# Autodesk Inventor assembly: Assembly1
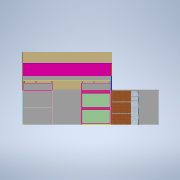
[picture p0: Inventor's stored thumbnail of the model, 180x180]
Saved by Autodesk Inventor 2022.6 (Build 266554000, 554)
## iProperties
RuleStatus: InUse
Created: 2026-10-19
Part Number: Assembly1
Document SubType Name: Assembly
Designer: Dragos Macovei
Author: Dragos Macovei
## Documents named in this file (55)
- C:\Users\Dragos Macovei\Documents\3D_Parts\PAT ADI\Assembly1.iam
- C:\Users\Dragos Macovei\Documents\3D_Parts\PAT ADI\despartitor_sub_pat_mare.ipt
- C:\Users\Dragos Macovei\Documents\3D_Parts\PAT ADI\assembly_sterar_superior.iam
- C:\Users\Dragos Macovei\Documents\3D_Parts\PAT ADI\assembly_sertar_inferior.iam
- C:\Users\Dragos Macovei\Documents\3D_Parts\PAT ADI\rigla_lemn_rindeluita_18x60x200.ipt
- C:\Users\Dragos Macovei\Documents\3D_Parts\PAT ADI\despartitor_sub_pat_mai_scurt_pe_culoar_mijloc.ipt
- C:\Users\Dragos Macovei\Documents\3D_Parts\PAT ADI\tablie_lungime_pat.ipt
- C:\Users\Dragos Macovei\Documents\3D_Parts\PAT ADI\blat_deasupra_sertarelor_de_la_pat.ipt
- C:\Users\Dragos Macovei\Documents\3D_Parts\PAT ADI\polita_sertar.ipt
- C:\Users\Dragos Macovei\Documents\3D_Parts\PAT ADI\cant_superior_sertare_sus.ipt
- C:\Users\Dragos Macovei\Documents\3D_Parts\PAT ADI\front_sertar_superior.ipt
- C:\Users\Dragos Macovei\Documents\3D_Parts\PAT ADI\front_usa_mid.ipt
- C:\Users\Dragos Macovei\Documents\3D_Parts\PAT ADI\front_sertar_mijlociu.ipt
- C:\Users\Dragos Macovei\Documents\3D_Parts\PAT ADI\jumatate_tablie_pat_jos.ipt
- C:\Users\Dragos Macovei\Documents\3D_Parts\PAT ADI\jumatate_tablie_pat_sus_cap.ipt
- C:\Users\Dragos Macovei\Documents\3D_Parts\PAT ADI\jumatate_tablie_pat_sus_picioare.ipt
- C:\Users\Dragos Macovei\Documents\3D_Parts\PAT ADI\capac_noptiera.ipt
- C:\Users\Dragos Macovei\Documents\3D_Parts\PAT ADI\dop_noptiera_picioare.ipt
- C:\Users\Dragos Macovei\Documents\3D_Parts\PAT ADI\rigla_lemn_rindeluita_18x60_dar_taiata_mai_mica.ipt
- C:\Users\Dragos Macovei\Documents\3D_Parts\PAT ADI\spate_sertare.ipt
- C:\Users\Dragos Macovei\Documents\3D_Parts\PAT ADI\balustrada_pal.ipt
- C:\Users\Dragos Macovei\Documents\3D_Parts\PAT ADI\laterala_treapta_jos.ipt
- C:\Users\Dragos Macovei\Documents\3D_Parts\PAT ADI\Treapta_1_capac.ipt
- C:\Users\Dragos Macovei\Documents\3D_Parts\PAT ADI\front_scara_sus.ipt
- C:\Users\Dragos Macovei\Documents\3D_Parts\PAT ADI\laterala_treapta_mijloc.ipt
- C:\Users\Dragos Macovei\Documents\3D_Parts\PAT ADI\laterala_treapta_sus.ipt
- C:\Users\Dragos Macovei\Documents\3D_Parts\PAT ADI\suport_Treapta_1_capac.ipt
- C:\Users\Dragos Macovei\Documents\3D_Parts\PAT ADI\suport_front_scara_sus.ipt
- C:\Users\Dragos Macovei\Documents\3D_Parts\PAT ADI\jumatate_tablie_pat_jos_la_picioare_unde_vin_treptele.ipt
- C:\Users\Dragos Macovei\Documents\3D_Parts\PAT ADI\blat.ipt
- C:\Users\Dragos Macovei\Documents\3D_Parts\PAT ADI\verticala_partea_dreapta_scara_jos.ipt
- C:\Users\Dragos Macovei\Documents\3D_Parts\PAT ADI\verticala_partea_dreapta_scara_mid.ipt
- C:\Users\Dragos Macovei\Documents\3D_Parts\PAT ADI\verticala_partea_dreapta_scara_sus.ipt
- C:\Users\Dragos Macovei\Documents\3D_Parts\PAT ADI\podea_scari_jos_pe_parchet.ipt
- C:\Users\Dragos Macovei\Documents\3D_Parts\PAT ADI\ultima verticala la tevi.ipt
- C:\Users\Dragos Macovei\Documents\3D_Parts\PAT ADI\suport_colt_teava.ipt
- C:\Users\Dragos Macovei\Documents\3D_Parts\PAT ADI\prindere_sub_blat_cutia_de_la_calorifer.ipt
- C:\Users\Dragos Macovei\Documents\3D_Parts\PAT ADI\polita_spatiu_liber_dintre_scara_si_box.ipt
- C:\Users\Dragos Macovei\Documents\3D_Parts\PAT ADI\laterala_box_sertare.ipt
- C:\Users\Dragos Macovei\Documents\3D_Parts\PAT ADI\top-bottom_box_sertare.ipt
- C:\Users\Dragos Macovei\Documents\3D_Parts\PAT ADI\sertar_inferior_trepte_assmbly.iam
- C:\Users\Dragos Macovei\Documents\3D_Parts\PAT ADI\sertar_superior_trepte.iam
- C:\Users\Dragos Macovei\Documents\3D_Parts\PAT ADI\front_sertare_dreapta_birou.ipt
- C:\Users\Dragos Macovei\Documents\3D_Parts\PAT ADI\front_sertar_scari.ipt
- C:\Users\Dragos Macovei\Documents\3D_Parts\PAT ADI\front_usa_box_tevi_apa.ipt
- C:\Users\Dragos Macovei\Documents\3D_Parts\PAT ADI\pfl_spate_corp_tevi_apa.ipt
- C:\Users\Dragos Macovei\Documents\3D_Parts\PAT ADI\front_suport_telefon_lateral.ipt
- C:\Users\Dragos Macovei\Documents\3D_Parts\PAT ADI\front_picioare_cutie_suport_telefon.ipt
- C:\Users\Dragos Macovei\Documents\3D_Parts\PAT ADI\pfl_spate_corp_3_sertare.ipt
- C:\Users\Dragos Macovei\Documents\3D_Parts\PAT ADI\intaritura_partea_din_spate_trepte.ipt
- C:\Users\Dragos Macovei\Documents\3D_Parts\PAT ADI\front_suport_telefon_sus.ipt
- C:\Users\Dragos Macovei\Documents\3D_Parts\PAT ADI\intaritura_partea_din_spate_cutie_tevi_cu_usa.ipt
- C:\Users\Dragos Macovei\Documents\3D_Parts\PAT ADI\spate_pat_partea_unde_era_gol.ipt
- C:\Users\Dragos Macovei\Documents\3D_Parts\PAT ADI\saltea.ipt
- C:\Users\Dragos Macovei\Documents\3D_Parts\PAT ADI\sertar_treapta_3_pat.iam
## Components (97 placed, 54 different names)
1. front_sertar_superior:1 — Mate:100, Flush:60, Flush:61
2. front_sertar_superior:2 — Mate:101, Flush:62, Flush:63, Mate:104, Mate:110
3. front_usa_mid:1 — Mate:103, Mate:104, Flush:64
4. front_sertar_mijlociu:1 — Mate:106, Flush:66, Flush:67, Mate:107, Flush:208, Mate:244
5. front_sertar_mijlociu:2 — Mate:105, Flush:65, Mate:107, Mate:245
6. front_sertar_mijlociu:3 — Mate:108, Flush:70, Mate:110, Mate:241
7. front_sertar_mijlociu:4 — Mate:109, Flush:69, Flush:208, Mate:240
8. rigla_lemn_rindeluita_18x60x200:9 — Flush:48, Flush:50, Flush:51, Flush:52, Flush:53, Flush:78, Mate:118, Mate:129
9. rigla_lemn_rindeluita_18x60x200:10 — Flush:46, Flush:47, Mate:117, Flush:76, Flush:77, Mate:120, Mate:121
10. rigla_lemn_rindeluita_18x60x200:11 — Flush:47, Flush:48, Flush:76, Mate:119, Mate:120, Mate:305
11. rigla_lemn_rindeluita_18x60x200:14 — Flush:46, Flush:49, Flush:50, Flush:51, Flush:52, Mate:115, Mate:122, Mate:136
12. rigla_lemn_rindeluita_18x60x200:13 — Flush:53, Flush:77, Flush:78, Mate:118, Mate:119
13. rigla_lemn_rindeluita_18x60x200:12 — Flush:49, Mate:97, Mate:116, Mate:121, Mate:122
14. rigla_lemn_rindeluita_18x60x200:15 — Mate:146
15. rigla_lemn_rindeluita_18x60x200:16 — Flush:91
16. rigla_lemn_rindeluita_18x60x200:17
17. rigla_lemn_rindeluita_18x60x200:18 — Flush:90
18. rigla_lemn_rindeluita_18x60x200:19
19. rigla_lemn_rindeluita_18x60x200:20 — Mate:128, Flush:90, Flush:91, Mate:129, Mate:132
20. rigla_lemn_rindeluita_18x60_dar_taiata_mai_mica:7 — Mate:270, Mate:271, Mate:272
21. rigla_lemn_rindeluita_18x60_dar_taiata_mai_mica:6 — Mate:163, Mate:164, Mate:269
22. rigla_lemn_rindeluita_18x60_dar_taiata_mai_mica:1 — Mate:150, Mate:151, Flush:101, Mate:269
23. rigla_lemn_rindeluita_18x60_dar_taiata_mai_mica:2 — Mate:152, Mate:155, Flush:102, Mate:272
24. rigla_lemn_rindeluita_18x60_dar_taiata_mai_mica:3 — Mate:153, Mate:156, Flush:103
25. rigla_lemn_rindeluita_18x60_dar_taiata_mai_mica:4 — Mate:154, Mate:157, Flush:104
26. rigla_lemn_rindeluita_18x60x200:21 — Mate:145, Mate:146
27. despartitor_sub_pat_mare:1 — Flush:3, Flush:4, Mate:6, Mate:10, Mate:101, Flush:62, Mate:108, Mate:109, Flush:69, Flush:70, Mate:131, Mate:157, Flush:104, Mate:160, Mate:196, Flush:148, Flush:149, Flush:150, Flush:152, Mate:237, Flush:201, Flush:202, Mate:282
28. despartitor_sub_pat_mare:4 — Flush:3, Flush:4, Mate:10, Mate:82, Flush:33, Flush:36, Flush:42, Flush:43, Flush:44, Mate:91, Flush:45, Mate:97, Mate:100, Flush:61, Mate:105, Mate:106, Flush:65, Flush:66, Flush:71, Flush:74, Mate:111, Mate:114, Mate:132, Mate:145, Mate:150, Flush:101, Flush:102, Flush:103
29. assembly_sterar_superior:1 [sub-assembly] — Flush:211, Flush:212, Mate:241
30. assembly_sterar_superior:2 [sub-assembly] — Flush:215, Flush:217, Mate:245
31. assembly_sertar_inferior:4 [sub-assembly] — Mate:6, Mate:239, Flush:205, Flush:210
32. assembly_sertar_inferior:5 [sub-assembly] — Flush:214, Flush:215, Flush:216, Flush:218, Mate:244
33. assembly_sertar_inferior:6 [sub-assembly] — Flush:205, Flush:209, Flush:210, Flush:211, Flush:212, Mate:240
34. assembly_sertar_inferior:7 [sub-assembly] — Flush:214, Flush:216, Flush:217, Mate:242, Mate:243
35. despartitor_sub_pat_mai_scurt_pe_culoar_mijloc:1 — Flush:42, Mate:90, Mate:102, Flush:59, Mate:156, Mate:158, Flush:106, Flush:218, Mate:243
36. despartitor_sub_pat_mai_scurt_pe_culoar_mijloc:2 — Flush:43, Flush:44, Mate:155, Mate:159, Mate:238, Flush:209
37. polita_sertar:2 — Mate:82, Flush:33, Flush:36, Mate:102, Flush:59, Flush:67, Flush:105, Mate:242
38. polita_sertar:6 — Mate:237, Flush:201, Flush:202, Mate:238, Flush:203, Mate:239
39. cant_superior_sertare_sus:1 — Mate:90, Mate:91, Flush:45, Flush:60, Flush:63, Mate:103, Flush:64, Mate:133
40. spate_sertare:2 — Mate:159, Mate:160, Mate:164, Flush:203, Mate:270
41. spate_sertare:1 — Mate:158, Flush:105, Flush:106
42. spate_pat_partea_unde_era_gol:1 — Mate:297, Flush:247, Flush:248
43. tablie_lungime_pat:1 — Flush:94, Mate:135, Mate:142, Mate:151, Mate:152, Mate:153, Mate:154, Mate:163, Flush:213, Mate:271, Mate:294, Mate:297, Flush:248
44. blat_deasupra_sertarelor_de_la_pat:4 — Mate:133, Mate:134, Flush:93, Mate:136, Mate:165, Flush:108
45. jumatate_tablie_pat_jos:1 — Flush:71, Flush:74, Mate:111, Mate:113, Flush:75, Flush:247
46. jumatate_tablie_pat_jos_la_picioare_unde_vin_treptele:1 — Mate:196, Mate:197, Flush:147, Flush:148, Flush:149, Mate:198, Mate:199, Mate:200, Mate:213
47. jumatate_tablie_pat_sus_cap:1 — Mate:113, Mate:114, Flush:75, Mate:115, Mate:116, Mate:117, Mate:128, Mate:134, Flush:93, Flush:94, Mate:135, Mate:141, Mate:166, Flush:213, Mate:284, Mate:292, Mate:303
48. jumatate_tablie_pat_sus_picioare:1 — Mate:131, Mate:197, Flush:147, Mate:280, Flush:240, Mate:287
49. front_suport_telefon_lateral:1 — Mate:284, Mate:298, Mate:310, Flush:250
50. dop_noptiera_picioare:1 — Mate:280, Flush:240, Flush:241, Mate:282, Mate:286
51. front_picioare_cutie_suport_telefon:1 — Mate:286, Mate:287, Flush:249, Flush:250
52. front_suport_telefon_sus:1 — Mate:292, Mate:293, Mate:294, Mate:298
53. capac_noptiera:1 — Mate:141, Mate:142, Flush:241, Mate:293, Mate:310, Flush:249
54. balustrada_pal:1 — Mate:165, Mate:166, Flush:108, Mate:304
55. laterala_treapta_jos:1 — Mate:175, Mate:188, Mate:199, Flush:152, Flush:160, Flush:166, Flush:180, Mate:247
56. front_scara_sus:1 — Flush:157, Mate:205, Mate:206, Mate:213, Mate:214, Mate:219, Mate:220, Flush:187, Mate:222, Flush:192, Flush:239
57. Treapta_1_capac:1 — Mate:193, Mate:210, Flush:176, Mate:215, Mate:266, Mate:307
58. Treapta_1_capac:2 — Mate:201, Mate:207, Flush:177, Mate:216, Mate:248, Mate:265
59. laterala_treapta_mijloc:1 — Mate:175, Mate:181, Flush:132, Mate:190, Mate:198, Flush:150, Flush:153, Flush:160, Flush:168, Flush:174, Mate:249
60. laterala_treapta_sus:1 — Mate:181, Flush:132, Mate:192, Mate:200, Flush:153, Mate:214, Mate:290, Mate:309
61. suport_Treapta_1_capac:1 — Mate:190, Mate:193, Mate:209, Flush:167, Flush:168
62. suport_Treapta_1_capac:2 — Mate:188, Mate:201, Mate:208, Flush:165, Flush:166
63. suport_front_scara_sus:1 — Mate:192, Flush:157, Mate:206, Mate:211, Flush:169, Flush:170, Mate:289
64. blat:1 — Mate:205, Mate:227, Flush:192, Mate:232, Flush:195, Flush:197, Mate:233
65. verticala_partea_dreapta_scara_jos:1 — Mate:207, Mate:208, Flush:165, Flush:175, Flush:177, Mate:218, Flush:181, Flush:219, Flush:232
66. verticala_partea_dreapta_scara_mid:1 — Mate:209, Mate:210, Flush:167, Flush:173, Flush:175, Flush:176, Mate:216, Flush:220, Flush:233
67. verticala_partea_dreapta_scara_sus:1 — Mate:211, Flush:169, Flush:170, Flush:173, Flush:174, Mate:215, Flush:183, Flush:184, Mate:221, Mate:229, Mate:230, Flush:193, Flush:234, Mate:268, Flush:245, Mate:306
68. podea_scari_jos_pe_parchet:1 — Flush:180, Mate:218, Flush:181, Mate:246, Flush:231
69. ultima verticala la tevi:1 — Mate:219, Flush:184, Flush:188, Mate:224, Mate:228, Flush:190, Mate:267, Flush:235, Flush:238
70. ultima verticala la tevi:2 — Mate:220, Flush:183, Mate:226, Flush:189, Mate:229, Mate:291, Mate:295, Flush:246
71. suport_colt_teava:1 — Flush:187, Mate:221, Mate:222, Mate:223, Mate:236
72. prindere_sub_blat_cutia_de_la_calorifer:1 — Flush:188, Mate:223, Mate:224, Mate:227, Mate:296
73. prindere_sub_blat_cutia_de_la_calorifer:2 — Mate:226, Flush:189, Mate:228, Flush:190, Flush:236
74. polita_spatiu_liber_dintre_scara_si_box:1 — Mate:230, Flush:193, Mate:236, Flush:237
75. laterala_box_sertare:1 — Flush:194, Flush:196, Flush:197, Flush:198, Flush:226, Mate:254, Flush:228, Flush:244
76. laterala_box_sertare:2 — Flush:194, Mate:232, Flush:195, Flush:196, Mate:234, Flush:199, Flush:200, Mate:235, Mate:252, Flush:229, Flush:230, Mate:288
77. top-bottom_box_sertare:1 — Flush:198, Mate:234, Flush:199, Mate:253, Mate:254, Flush:227, Flush:243
78. top-bottom_box_sertare:2 — Mate:233, Flush:200, Mate:235
79. sertar_inferior_trepte_assmbly:1 [sub-assembly] — Mate:246, Flush:219, Mate:247, Mate:262
80. sertar_inferior_trepte_assmbly:2 [sub-assembly] — Mate:248, Flush:220, Mate:249, Mate:263
81. sertar_superior_trepte:2 [sub-assembly] — Flush:223, Mate:252, Flush:224, Flush:225, Mate:253, Flush:226, Mate:255
82. sertar_superior_trepte:3 [sub-assembly] — Flush:222, Flush:224, Mate:258, Mate:260
83. sertar_superior_trepte:4 [sub-assembly] — Flush:222, Flush:223, Flush:225, Mate:256, Mate:257
84. front_sertare_dreapta_birou:1 — Mate:255, Flush:227, Flush:228, Mate:256, Mate:259
85. front_sertare_dreapta_birou:2 — Mate:258, Mate:261, Flush:230
86. front_sertare_dreapta_birou:3 — Mate:257, Mate:259, Flush:229, Mate:260, Mate:261
87. front_sertar_scari:1 — Mate:262, Flush:231, Flush:232
88. front_sertar_scari:2 — Mate:263, Mate:265, Flush:233
89. front_sertar_scari:3 — Mate:266, Flush:234, Mate:308, Mate:309
90. front_usa_box_tevi_apa:1 — Mate:267, Flush:235, Flush:236
91. polita_spatiu_liber_dintre_scara_si_box:2 — Flush:237, Mate:291
92. pfl_spate_corp_tevi_apa:1 — Mate:268, Flush:238, Flush:239
93. pfl_spate_corp_3_sertare:1 — Mate:288, Flush:243, Flush:244
94. intaritura_partea_din_spate_trepte:1 — Mate:289, Flush:245, Mate:290
95. intaritura_partea_din_spate_cutie_tevi_cu_usa:1 — Mate:295, Flush:246, Mate:296
96. saltea:1 — Mate:303, Mate:304, Mate:305
97. sertar_treapta_3_pat:1 [sub-assembly] — Mate:306, Mate:307, Mate:308
## Relationships (294: Mate 157, Flush 137)
- Flush:3: despartitor_sub_pat_mare:1 ↔ despartitor_sub_pat_mare:4
- Flush:4: despartitor_sub_pat_mare:1 ↔ despartitor_sub_pat_mare:4
- Mate:6 (6.5 mm): despartitor_sub_pat_mare:1 ↔ assembly_sertar_inferior:4
- Mate:10 (1982 mm): despartitor_sub_pat_mare:1 ↔ despartitor_sub_pat_mare:4
- Mate:82: despartitor_sub_pat_mare:4 ↔ polita_sertar:2
- Flush:33: despartitor_sub_pat_mare:4 ↔ polita_sertar:2
- Flush:36: despartitor_sub_pat_mare:4 ↔ polita_sertar:2
- Flush:42: despartitor_sub_pat_mare:4 ↔ despartitor_sub_pat_mai_scurt_pe_culoar_mijloc:1
- Flush:43: despartitor_sub_pat_mare:4 ↔ despartitor_sub_pat_mai_scurt_pe_culoar_mijloc:2
- Flush:44: despartitor_sub_pat_mare:4 ↔ despartitor_sub_pat_mai_scurt_pe_culoar_mijloc:2
- Mate:90: despartitor_sub_pat_mai_scurt_pe_culoar_mijloc:1 ↔ cant_superior_sertare_sus:1
- Mate:91: despartitor_sub_pat_mare:4 ↔ cant_superior_sertare_sus:1
- Flush:45: despartitor_sub_pat_mare:4 ↔ cant_superior_sertare_sus:1
- Flush:46: rigla_lemn_rindeluita_18x60x200:10 ↔ rigla_lemn_rindeluita_18x60x200:14
- Flush:47: rigla_lemn_rindeluita_18x60x200:10 ↔ rigla_lemn_rindeluita_18x60x200:11
- Flush:48: rigla_lemn_rindeluita_18x60x200:9 ↔ rigla_lemn_rindeluita_18x60x200:11
- Flush:49: rigla_lemn_rindeluita_18x60x200:14 ↔ rigla_lemn_rindeluita_18x60x200:12
- Flush:50: rigla_lemn_rindeluita_18x60x200:9 ↔ rigla_lemn_rindeluita_18x60x200:14
- Flush:51: rigla_lemn_rindeluita_18x60x200:9 ↔ rigla_lemn_rindeluita_18x60x200:14
- Flush:52: rigla_lemn_rindeluita_18x60x200:9 ↔ rigla_lemn_rindeluita_18x60x200:14
- Flush:53: rigla_lemn_rindeluita_18x60x200:9 ↔ rigla_lemn_rindeluita_18x60x200:13
- Mate:97: rigla_lemn_rindeluita_18x60x200:12 ↔ despartitor_sub_pat_mare:4
- Mate:100: front_sertar_superior:1 ↔ despartitor_sub_pat_mare:4
- Mate:101: front_sertar_superior:2 ↔ despartitor_sub_pat_mare:1
- Mate:102: despartitor_sub_pat_mai_scurt_pe_culoar_mijloc:1 ↔ polita_sertar:2
- Flush:59: despartitor_sub_pat_mai_scurt_pe_culoar_mijloc:1 ↔ polita_sertar:2
- Flush:60 (3 mm): front_sertar_superior:1 ↔ cant_superior_sertare_sus:1
- Flush:61 (3 mm): front_sertar_superior:1 ↔ despartitor_sub_pat_mare:4
- Flush:62 (3 mm): front_sertar_superior:2 ↔ despartitor_sub_pat_mare:1
- Flush:63 (-3 mm): front_sertar_superior:2 ↔ cant_superior_sertare_sus:1
- Mate:103: front_usa_mid:1 ↔ cant_superior_sertare_sus:1
- Mate:104 (3 mm): front_sertar_superior:2 ↔ front_usa_mid:1
- Flush:64 (3 mm): front_usa_mid:1 ↔ cant_superior_sertare_sus:1
- Mate:105: front_sertar_mijlociu:2 ↔ despartitor_sub_pat_mare:4
- Mate:106: front_sertar_mijlociu:1 ↔ despartitor_sub_pat_mare:4
- Flush:65 (3 mm): front_sertar_mijlociu:2 ↔ despartitor_sub_pat_mare:4
- Flush:66 (3 mm): front_sertar_mijlociu:1 ↔ despartitor_sub_pat_mare:4
- Flush:67 (4 mm): front_sertar_mijlociu:1 ↔ polita_sertar:2
- Mate:107 (3 mm): front_sertar_mijlociu:1 ↔ front_sertar_mijlociu:2
- Mate:108: front_sertar_mijlociu:3 ↔ despartitor_sub_pat_mare:1
- Mate:109: front_sertar_mijlociu:4 ↔ despartitor_sub_pat_mare:1
- Flush:69 (3 mm): front_sertar_mijlociu:4 ↔ despartitor_sub_pat_mare:1
- Flush:70 (3 mm): front_sertar_mijlociu:3 ↔ despartitor_sub_pat_mare:1
- Mate:110 (3 mm): front_sertar_superior:2 ↔ front_sertar_mijlociu:3
- Flush:71: despartitor_sub_pat_mare:4 ↔ jumatate_tablie_pat_jos:1
- Flush:74: despartitor_sub_pat_mare:4 ↔ jumatate_tablie_pat_jos:1
- Mate:111: despartitor_sub_pat_mare:4 ↔ jumatate_tablie_pat_jos:1
- Mate:113: jumatate_tablie_pat_jos:1 ↔ jumatate_tablie_pat_sus_cap:1
- Mate:114: despartitor_sub_pat_mare:4 ↔ jumatate_tablie_pat_sus_cap:1
- Flush:75: jumatate_tablie_pat_jos:1 ↔ jumatate_tablie_pat_sus_cap:1
- Mate:115: rigla_lemn_rindeluita_18x60x200:14 ↔ jumatate_tablie_pat_sus_cap:1
- Mate:116: rigla_lemn_rindeluita_18x60x200:12 ↔ jumatate_tablie_pat_sus_cap:1
- Mate:117: rigla_lemn_rindeluita_18x60x200:10 ↔ jumatate_tablie_pat_sus_cap:1
- Flush:76: rigla_lemn_rindeluita_18x60x200:10 ↔ rigla_lemn_rindeluita_18x60x200:11
- Flush:77: rigla_lemn_rindeluita_18x60x200:10 ↔ rigla_lemn_rindeluita_18x60x200:13
- Flush:78: rigla_lemn_rindeluita_18x60x200:9 ↔ rigla_lemn_rindeluita_18x60x200:13
- Mate:118 (30 mm): rigla_lemn_rindeluita_18x60x200:9 ↔ rigla_lemn_rindeluita_18x60x200:13
- Mate:119 (30 mm): rigla_lemn_rindeluita_18x60x200:11 ↔ rigla_lemn_rindeluita_18x60x200:13
- Mate:120 (30 mm): rigla_lemn_rindeluita_18x60x200:10 ↔ rigla_lemn_rindeluita_18x60x200:11
- Mate:121 (30 mm): rigla_lemn_rindeluita_18x60x200:10 ↔ rigla_lemn_rindeluita_18x60x200:12
- Mate:122 (30 mm): rigla_lemn_rindeluita_18x60x200:14 ↔ rigla_lemn_rindeluita_18x60x200:12
- [Flush]: rigla_lemn_rindeluita_18x60x200:16 ↔ rigla_lemn_rindeluita_18x60x200:20
- [Flush]: rigla_lemn_rindeluita_18x60x200:16 ↔ rigla_lemn_rindeluita_18x60x200:17
- [Flush]: rigla_lemn_rindeluita_18x60x200:15 ↔ rigla_lemn_rindeluita_18x60x200:17
- [Flush]: rigla_lemn_rindeluita_18x60x200:18 ↔ rigla_lemn_rindeluita_18x60x200:20
- [Flush]: rigla_lemn_rindeluita_18x60x200:15 ↔ rigla_lemn_rindeluita_18x60x200:20
- [Flush]: rigla_lemn_rindeluita_18x60x200:15 ↔ rigla_lemn_rindeluita_18x60x200:20
- [Flush]: rigla_lemn_rindeluita_18x60x200:15 ↔ rigla_lemn_rindeluita_18x60x200:20
- [Flush]: rigla_lemn_rindeluita_18x60x200:15 ↔ rigla_lemn_rindeluita_18x60x200:19
- [Flush]: rigla_lemn_rindeluita_18x60x200:16 ↔ rigla_lemn_rindeluita_18x60x200:17
- [Flush]: rigla_lemn_rindeluita_18x60x200:16 ↔ rigla_lemn_rindeluita_18x60x200:19
- [Flush]: rigla_lemn_rindeluita_18x60x200:15 ↔ rigla_lemn_rindeluita_18x60x200:19
- [Mate] (30 mm): rigla_lemn_rindeluita_18x60x200:15 ↔ rigla_lemn_rindeluita_18x60x200:19
- [Mate] (30 mm): rigla_lemn_rindeluita_18x60x200:17 ↔ rigla_lemn_rindeluita_18x60x200:19
- [Mate] (30 mm): rigla_lemn_rindeluita_18x60x200:16 ↔ rigla_lemn_rindeluita_18x60x200:17
- [Mate] (30 mm): rigla_lemn_rindeluita_18x60x200:16 ↔ rigla_lemn_rindeluita_18x60x200:18
- [Mate] (30 mm): rigla_lemn_rindeluita_18x60x200:18 ↔ rigla_lemn_rindeluita_18x60x200:20
- Mate:128: rigla_lemn_rindeluita_18x60x200:20 ↔ jumatate_tablie_pat_sus_cap:1
- Flush:90: rigla_lemn_rindeluita_18x60x200:18 ↔ rigla_lemn_rindeluita_18x60x200:20
- Flush:91: rigla_lemn_rindeluita_18x60x200:16 ↔ rigla_lemn_rindeluita_18x60x200:20
- Mate:129 (30 mm): rigla_lemn_rindeluita_18x60x200:9 ↔ rigla_lemn_rindeluita_18x60x200:20
- Mate:131: despartitor_sub_pat_mare:1 ↔ jumatate_tablie_pat_sus_picioare:1
- Mate:132: rigla_lemn_rindeluita_18x60x200:20 ↔ despartitor_sub_pat_mare:4
- Mate:133: cant_superior_sertare_sus:1 ↔ blat_deasupra_sertarelor_de_la_pat:4
- Mate:134: blat_deasupra_sertarelor_de_la_pat:4 ↔ jumatate_tablie_pat_sus_cap:1
- Flush:93: blat_deasupra_sertarelor_de_la_pat:4 ↔ jumatate_tablie_pat_sus_cap:1
- Flush:94: tablie_lungime_pat:1 ↔ jumatate_tablie_pat_sus_cap:1
- Mate:135: tablie_lungime_pat:1 ↔ jumatate_tablie_pat_sus_cap:1
- Mate:136 (30 mm): rigla_lemn_rindeluita_18x60x200:14 ↔ blat_deasupra_sertarelor_de_la_pat:4
- Mate:141: jumatate_tablie_pat_sus_cap:1 ↔ capac_noptiera:1
- Mate:142: tablie_lungime_pat:1 ↔ capac_noptiera:1
- Mate:145: rigla_lemn_rindeluita_18x60x200:21 ↔ despartitor_sub_pat_mare:4
- Mate:146 (30 mm): rigla_lemn_rindeluita_18x60x200:15 ↔ rigla_lemn_rindeluita_18x60x200:21
- Mate:150: rigla_lemn_rindeluita_18x60_dar_taiata_mai_mica:1 ↔ despartitor_sub_pat_mare:4
- Mate:151: rigla_lemn_rindeluita_18x60_dar_taiata_mai_mica:1 ↔ tablie_lungime_pat:1
- Flush:101: rigla_lemn_rindeluita_18x60_dar_taiata_mai_mica:1 ↔ despartitor_sub_pat_mare:4
- Mate:152: rigla_lemn_rindeluita_18x60_dar_taiata_mai_mica:2 ↔ tablie_lungime_pat:1
- Mate:153: rigla_lemn_rindeluita_18x60_dar_taiata_mai_mica:3 ↔ tablie_lungime_pat:1
- Mate:154: rigla_lemn_rindeluita_18x60_dar_taiata_mai_mica:4 ↔ tablie_lungime_pat:1
- Mate:155: rigla_lemn_rindeluita_18x60_dar_taiata_mai_mica:2 ↔ despartitor_sub_pat_mai_scurt_pe_culoar_mijloc:2
- Mate:156: rigla_lemn_rindeluita_18x60_dar_taiata_mai_mica:3 ↔ despartitor_sub_pat_mai_scurt_pe_culoar_mijloc:1
- Mate:157: rigla_lemn_rindeluita_18x60_dar_taiata_mai_mica:4 ↔ despartitor_sub_pat_mare:1
- Flush:102: rigla_lemn_rindeluita_18x60_dar_taiata_mai_mica:2 ↔ despartitor_sub_pat_mare:4
- Flush:103: rigla_lemn_rindeluita_18x60_dar_taiata_mai_mica:3 ↔ despartitor_sub_pat_mare:4
- Flush:104: rigla_lemn_rindeluita_18x60_dar_taiata_mai_mica:4 ↔ despartitor_sub_pat_mare:1
- Mate:158: despartitor_sub_pat_mai_scurt_pe_culoar_mijloc:1 ↔ spate_sertare:1
- Flush:105: polita_sertar:2 ↔ spate_sertare:1
- Flush:106: despartitor_sub_pat_mai_scurt_pe_culoar_mijloc:1 ↔ spate_sertare:1
- Mate:159: despartitor_sub_pat_mai_scurt_pe_culoar_mijloc:2 ↔ spate_sertare:2
- Mate:160: despartitor_sub_pat_mare:1 ↔ spate_sertare:2
- Mate:163: rigla_lemn_rindeluita_18x60_dar_taiata_mai_mica:6 ↔ tablie_lungime_pat:1
- Mate:164: rigla_lemn_rindeluita_18x60_dar_taiata_mai_mica:6 ↔ spate_sertare:2
- Mate:165: blat_deasupra_sertarelor_de_la_pat:4 ↔ balustrada_pal:1
- Mate:166: jumatate_tablie_pat_sus_cap:1 ↔ balustrada_pal:1
- Flush:108: blat_deasupra_sertarelor_de_la_pat:4 ↔ balustrada_pal:1
- Mate:175: laterala_treapta_jos:1 ↔ laterala_treapta_mijloc:1
- Mate:181: laterala_treapta_mijloc:1 ↔ laterala_treapta_sus:1
- Flush:132: laterala_treapta_mijloc:1 ↔ laterala_treapta_sus:1
- Mate:188: laterala_treapta_jos:1 ↔ suport_Treapta_1_capac:2
- Mate:190: laterala_treapta_mijloc:1 ↔ suport_Treapta_1_capac:1
- Mate:192: laterala_treapta_sus:1 ↔ suport_front_scara_sus:1
- Mate:193: Treapta_1_capac:1 ↔ suport_Treapta_1_capac:1
- Mate:196: despartitor_sub_pat_mare:1 ↔ jumatate_tablie_pat_jos_la_picioare_unde_vin_treptele:1
- Mate:197: jumatate_tablie_pat_jos_la_picioare_unde_vin_treptele:1 ↔ jumatate_tablie_pat_sus_picioare:1
- Flush:147: jumatate_tablie_pat_jos_la_picioare_unde_vin_treptele:1 ↔ jumatate_tablie_pat_sus_picioare:1
- Flush:148: despartitor_sub_pat_mare:1 ↔ jumatate_tablie_pat_jos_la_picioare_unde_vin_treptele:1
- Flush:149: despartitor_sub_pat_mare:1 ↔ jumatate_tablie_pat_jos_la_picioare_unde_vin_treptele:1
- Mate:198: jumatate_tablie_pat_jos_la_picioare_unde_vin_treptele:1 ↔ laterala_treapta_mijloc:1
- Flush:150 (-18 mm): despartitor_sub_pat_mare:1 ↔ laterala_treapta_mijloc:1
- Mate:199: jumatate_tablie_pat_jos_la_picioare_unde_vin_treptele:1 ↔ laterala_treapta_jos:1
- Flush:152: despartitor_sub_pat_mare:1 ↔ laterala_treapta_jos:1
- Mate:200: jumatate_tablie_pat_jos_la_picioare_unde_vin_treptele:1 ↔ laterala_treapta_sus:1
- Flush:153: laterala_treapta_mijloc:1 ↔ laterala_treapta_sus:1
- Mate:201: Treapta_1_capac:2 ↔ suport_Treapta_1_capac:2
- Flush:157: front_scara_sus:1 ↔ suport_front_scara_sus:1
- Flush:160: laterala_treapta_jos:1 ↔ laterala_treapta_mijloc:1
- Mate:205: front_scara_sus:1 ↔ blat:1
- Mate:206: front_scara_sus:1 ↔ suport_front_scara_sus:1
- Mate:207: Treapta_1_capac:2 ↔ verticala_partea_dreapta_scara_jos:1
- Mate:208: suport_Treapta_1_capac:2 ↔ verticala_partea_dreapta_scara_jos:1
- Flush:165: suport_Treapta_1_capac:2 ↔ verticala_partea_dreapta_scara_jos:1
- Flush:166: laterala_treapta_jos:1 ↔ suport_Treapta_1_capac:2
- Mate:209: suport_Treapta_1_capac:1 ↔ verticala_partea_dreapta_scara_mid:1
- Mate:210: Treapta_1_capac:1 ↔ verticala_partea_dreapta_scara_mid:1
- Flush:167: suport_Treapta_1_capac:1 ↔ verticala_partea_dreapta_scara_mid:1
- Flush:168: laterala_treapta_mijloc:1 ↔ suport_Treapta_1_capac:1
- Mate:211: suport_front_scara_sus:1 ↔ verticala_partea_dreapta_scara_sus:1
- Flush:169: suport_front_scara_sus:1 ↔ verticala_partea_dreapta_scara_sus:1
- Flush:170: suport_front_scara_sus:1 ↔ verticala_partea_dreapta_scara_sus:1
- Mate:213: jumatate_tablie_pat_jos_la_picioare_unde_vin_treptele:1 ↔ front_scara_sus:1
- Flush:173: verticala_partea_dreapta_scara_mid:1 ↔ verticala_partea_dreapta_scara_sus:1
- Flush:174: laterala_treapta_mijloc:1 ↔ verticala_partea_dreapta_scara_sus:1
- Flush:175: verticala_partea_dreapta_scara_jos:1 ↔ verticala_partea_dreapta_scara_mid:1
- Mate:214: front_scara_sus:1 ↔ laterala_treapta_sus:1
- Flush:176: Treapta_1_capac:1 ↔ verticala_partea_dreapta_scara_mid:1
- Flush:177: Treapta_1_capac:2 ↔ verticala_partea_dreapta_scara_jos:1
- Mate:215: Treapta_1_capac:1 ↔ verticala_partea_dreapta_scara_sus:1
- Mate:216: Treapta_1_capac:2 ↔ verticala_partea_dreapta_scara_mid:1
- Flush:180: laterala_treapta_jos:1 ↔ podea_scari_jos_pe_parchet:1
- Mate:218: verticala_partea_dreapta_scara_jos:1 ↔ podea_scari_jos_pe_parchet:1
- Flush:181: verticala_partea_dreapta_scara_jos:1 ↔ podea_scari_jos_pe_parchet:1
- Mate:219 (18 mm): front_scara_sus:1 ↔ ultima verticala la tevi:1
- Mate:220 (18 mm): front_scara_sus:1 ↔ ultima verticala la tevi:2
- Flush:183: verticala_partea_dreapta_scara_sus:1 ↔ ultima verticala la tevi:2
- Flush:184: verticala_partea_dreapta_scara_sus:1 ↔ ultima verticala la tevi:1
- Flush:187: front_scara_sus:1 ↔ suport_colt_teava:1
- Mate:221: verticala_partea_dreapta_scara_sus:1 ↔ suport_colt_teava:1
- Mate:222: front_scara_sus:1 ↔ suport_colt_teava:1
- Flush:188: ultima verticala la tevi:1 ↔ prindere_sub_blat_cutia_de_la_calorifer:1
- Mate:223: suport_colt_teava:1 ↔ prindere_sub_blat_cutia_de_la_calorifer:1
- Mate:224: ultima verticala la tevi:1 ↔ prindere_sub_blat_cutia_de_la_calorifer:1
- Mate:226: ultima verticala la tevi:2 ↔ prindere_sub_blat_cutia_de_la_calorifer:2
- Flush:189: ultima verticala la tevi:2 ↔ prindere_sub_blat_cutia_de_la_calorifer:2
- Mate:227: blat:1 ↔ prindere_sub_blat_cutia_de_la_calorifer:1
- Mate:228: ultima verticala la tevi:1 ↔ prindere_sub_blat_cutia_de_la_calorifer:2
- Flush:190: ultima verticala la tevi:1 ↔ prindere_sub_blat_cutia_de_la_calorifer:2
- Flush:192: front_scara_sus:1 ↔ blat:1
- Mate:229 (160 mm): verticala_partea_dreapta_scara_sus:1 ↔ ultima verticala la tevi:2
- Mate:230: verticala_partea_dreapta_scara_sus:1 ↔ polita_spatiu_liber_dintre_scara_si_box:1
- Flush:193: verticala_partea_dreapta_scara_sus:1 ↔ polita_spatiu_liber_dintre_scara_si_box:1
- Flush:194: laterala_box_sertare:1 ↔ laterala_box_sertare:2
- Mate:232: blat:1 ↔ laterala_box_sertare:2
- Flush:195 (18 mm): blat:1 ↔ laterala_box_sertare:2
- Flush:196: laterala_box_sertare:1 ↔ laterala_box_sertare:2
- Flush:197: blat:1 ↔ laterala_box_sertare:1
- Mate:233: blat:1 ↔ top-bottom_box_sertare:2
- Flush:198: laterala_box_sertare:1 ↔ top-bottom_box_sertare:1
- Mate:234: laterala_box_sertare:2 ↔ top-bottom_box_sertare:1
- Flush:199: laterala_box_sertare:2 ↔ top-bottom_box_sertare:1
- Flush:200: laterala_box_sertare:2 ↔ top-bottom_box_sertare:2
- Mate:235: laterala_box_sertare:2 ↔ top-bottom_box_sertare:2
- Mate:236 (200 mm): suport_colt_teava:1 ↔ polita_spatiu_liber_dintre_scara_si_box:1
- Mate:237: despartitor_sub_pat_mare:1 ↔ polita_sertar:6
- Flush:201: despartitor_sub_pat_mare:1 ↔ polita_sertar:6
- Flush:202: despartitor_sub_pat_mare:1 ↔ polita_sertar:6
- Mate:238: despartitor_sub_pat_mai_scurt_pe_culoar_mijloc:2 ↔ polita_sertar:6
- Flush:203: polita_sertar:6 ↔ spate_sertare:2
- Mate:239 (30 mm): assembly_sertar_inferior:4 ↔ polita_sertar:6
- Flush:205: assembly_sertar_inferior:4 ↔ assembly_sertar_inferior:6
- Flush:208: front_sertar_mijlociu:1 ↔ front_sertar_mijlociu:4
- Flush:209: assembly_sertar_inferior:6 ↔ despartitor_sub_pat_mai_scurt_pe_culoar_mijloc:2
- Flush:210: assembly_sertar_inferior:4 ↔ assembly_sertar_inferior:6
- Flush:211: assembly_sterar_superior:1 ↔ assembly_sertar_inferior:6
- Flush:212: assembly_sterar_superior:1 ↔ assembly_sertar_inferior:6
- Mate:240 (33 mm): front_sertar_mijlociu:4 ↔ assembly_sertar_inferior:6
- Mate:241 (33 mm): front_sertar_mijlociu:3 ↔ assembly_sterar_superior:1
- Flush:213: tablie_lungime_pat:1 ↔ jumatate_tablie_pat_sus_cap:1
- Flush:214: assembly_sertar_inferior:5 ↔ assembly_sertar_inferior:7
- Flush:215: assembly_sterar_superior:2 ↔ assembly_sertar_inferior:5
- Flush:216: assembly_sertar_inferior:5 ↔ assembly_sertar_inferior:7
- Flush:217: assembly_sterar_superior:2 ↔ assembly_sertar_inferior:7
- Flush:218: assembly_sertar_inferior:5 ↔ despartitor_sub_pat_mai_scurt_pe_culoar_mijloc:1
- Mate:242 (30 mm): assembly_sertar_inferior:7 ↔ polita_sertar:2
- Mate:243 (6.5 mm): assembly_sertar_inferior:7 ↔ despartitor_sub_pat_mai_scurt_pe_culoar_mijloc:1
- Mate:244 (33 mm): front_sertar_mijlociu:1 ↔ assembly_sertar_inferior:5
- Mate:245 (33 mm): front_sertar_mijlociu:2 ↔ assembly_sterar_superior:2
- Mate:246 (30 mm): podea_scari_jos_pe_parchet:1 ↔ sertar_inferior_trepte_assmbly:1
- Flush:219: verticala_partea_dreapta_scara_jos:1 ↔ sertar_inferior_trepte_assmbly:1
- Mate:247 (6.5 mm): laterala_treapta_jos:1 ↔ sertar_inferior_trepte_assmbly:1
- Mate:248 (30 mm): Treapta_1_capac:2 ↔ sertar_inferior_trepte_assmbly:2
- Flush:220: verticala_partea_dreapta_scara_mid:1 ↔ sertar_inferior_trepte_assmbly:2
- Mate:249 (6.5 mm): laterala_treapta_mijloc:1 ↔ sertar_inferior_trepte_assmbly:2
- Flush:222: sertar_superior_trepte:3 ↔ sertar_superior_trepte:4
- Flush:223: sertar_superior_trepte:2 ↔ sertar_superior_trepte:4
- Mate:252 (6.5 mm): laterala_box_sertare:2 ↔ sertar_superior_trepte:2
- Flush:224: sertar_superior_trepte:2 ↔ sertar_superior_trepte:3
- Flush:225: sertar_superior_trepte:2 ↔ sertar_superior_trepte:4
- Mate:253 (30 mm): top-bottom_box_sertare:1 ↔ sertar_superior_trepte:2
- Flush:226: laterala_box_sertare:1 ↔ sertar_superior_trepte:2
- Mate:254: laterala_box_sertare:1 ↔ top-bottom_box_sertare:1
- Mate:255: sertar_superior_trepte:2 ↔ front_sertare_dreapta_birou:1
- Flush:227 (4 mm): top-bottom_box_sertare:1 ↔ front_sertare_dreapta_birou:1
- Flush:228: laterala_box_sertare:1 ↔ front_sertare_dreapta_birou:1
- Mate:256 (33 mm): sertar_superior_trepte:4 ↔ front_sertare_dreapta_birou:1
- Mate:257: sertar_superior_trepte:4 ↔ front_sertare_dreapta_birou:3
- Mate:258: sertar_superior_trepte:3 ↔ front_sertare_dreapta_birou:2
- Mate:259 (3 mm): front_sertare_dreapta_birou:1 ↔ front_sertare_dreapta_birou:3
- Flush:229: laterala_box_sertare:2 ↔ front_sertare_dreapta_birou:3
- Mate:260 (33 mm): sertar_superior_trepte:3 ↔ front_sertare_dreapta_birou:3
- Mate:261 (3 mm): front_sertare_dreapta_birou:2 ↔ front_sertare_dreapta_birou:3
- Flush:230: laterala_box_sertare:2 ↔ front_sertare_dreapta_birou:2
- Mate:262: sertar_inferior_trepte_assmbly:1 ↔ front_sertar_scari:1
- Mate:263: sertar_inferior_trepte_assmbly:2 ↔ front_sertar_scari:2
- Flush:231 (3 mm): podea_scari_jos_pe_parchet:1 ↔ front_sertar_scari:1
- Mate:265 (3 mm): Treapta_1_capac:2 ↔ front_sertar_scari:2
- Mate:266 (3 mm): Treapta_1_capac:1 ↔ front_sertar_scari:3
- Flush:232: verticala_partea_dreapta_scara_jos:1 ↔ front_sertar_scari:1
- Flush:233: verticala_partea_dreapta_scara_mid:1 ↔ front_sertar_scari:2
- Flush:234: verticala_partea_dreapta_scara_sus:1 ↔ front_sertar_scari:3
- Mate:267: ultima verticala la tevi:1 ↔ front_usa_box_tevi_apa:1
- Flush:235: ultima verticala la tevi:1 ↔ front_usa_box_tevi_apa:1
- Flush:236 (2 mm): prindere_sub_blat_cutia_de_la_calorifer:2 ↔ front_usa_box_tevi_apa:1
- Flush:237: polita_spatiu_liber_dintre_scara_si_box:1 ↔ polita_spatiu_liber_dintre_scara_si_box:2
- Mate:268: verticala_partea_dreapta_scara_sus:1 ↔ pfl_spate_corp_tevi_apa:1
- Flush:238: ultima verticala la tevi:1 ↔ pfl_spate_corp_tevi_apa:1
- Flush:239: front_scara_sus:1 ↔ pfl_spate_corp_tevi_apa:1
- Mate:269 (250 mm): rigla_lemn_rindeluita_18x60_dar_taiata_mai_mica:6 ↔ rigla_lemn_rindeluita_18x60_dar_taiata_mai_mica:1
- Mate:270: rigla_lemn_rindeluita_18x60_dar_taiata_mai_mica:7 ↔ spate_sertare:2
- Mate:271: rigla_lemn_rindeluita_18x60_dar_taiata_mai_mica:7 ↔ tablie_lungime_pat:1
- Mate:272 (250 mm): rigla_lemn_rindeluita_18x60_dar_taiata_mai_mica:7 ↔ rigla_lemn_rindeluita_18x60_dar_taiata_mai_mica:2
- Mate:280: jumatate_tablie_pat_sus_picioare:1 ↔ dop_noptiera_picioare:1
- Flush:240: jumatate_tablie_pat_sus_picioare:1 ↔ dop_noptiera_picioare:1
- Flush:241: dop_noptiera_picioare:1 ↔ capac_noptiera:1
- Mate:282: despartitor_sub_pat_mare:1 ↔ dop_noptiera_picioare:1
- Mate:284: jumatate_tablie_pat_sus_cap:1 ↔ front_suport_telefon_lateral:1
- Mate:286: dop_noptiera_picioare:1 ↔ front_picioare_cutie_suport_telefon:1
- Mate:287: jumatate_tablie_pat_sus_picioare:1 ↔ front_picioare_cutie_suport_telefon:1
- Mate:288: laterala_box_sertare:2 ↔ pfl_spate_corp_3_sertare:1
- Flush:243: top-bottom_box_sertare:1 ↔ pfl_spate_corp_3_sertare:1
- Flush:244: laterala_box_sertare:1 ↔ pfl_spate_corp_3_sertare:1
- Mate:289: suport_front_scara_sus:1 ↔ intaritura_partea_din_spate_trepte:1
- Flush:245: verticala_partea_dreapta_scara_sus:1 ↔ intaritura_partea_din_spate_trepte:1
- Mate:290: laterala_treapta_sus:1 ↔ intaritura_partea_din_spate_trepte:1
- Mate:291: ultima verticala la tevi:2 ↔ polita_spatiu_liber_dintre_scara_si_box:2
- Mate:292: jumatate_tablie_pat_sus_cap:1 ↔ front_suport_telefon_sus:1
- Mate:293: front_suport_telefon_sus:1 ↔ capac_noptiera:1
- Mate:294: tablie_lungime_pat:1 ↔ front_suport_telefon_sus:1
- Mate:295: ultima verticala la tevi:2 ↔ intaritura_partea_din_spate_cutie_tevi_cu_usa:1
- Flush:246: ultima verticala la tevi:2 ↔ intaritura_partea_din_spate_cutie_tevi_cu_usa:1
- Mate:296: prindere_sub_blat_cutia_de_la_calorifer:1 ↔ intaritura_partea_din_spate_cutie_tevi_cu_usa:1
- Mate:297: spate_pat_partea_unde_era_gol:1 ↔ tablie_lungime_pat:1
- Flush:247: spate_pat_partea_unde_era_gol:1 ↔ jumatate_tablie_pat_jos:1
- Flush:248: spate_pat_partea_unde_era_gol:1 ↔ tablie_lungime_pat:1
- Mate:298: front_suport_telefon_lateral:1 ↔ front_suport_telefon_sus:1
- Mate:303: jumatate_tablie_pat_sus_cap:1 ↔ saltea:1
- Mate:304: balustrada_pal:1 ↔ saltea:1
- Mate:305: rigla_lemn_rindeluita_18x60x200:11 ↔ saltea:1
- Mate:306 (5.5 mm): verticala_partea_dreapta_scara_sus:1 ↔ sertar_treapta_3_pat:1
- Mate:307 (30 mm): Treapta_1_capac:1 ↔ sertar_treapta_3_pat:1
- Mate:308: front_sertar_scari:3 ↔ sertar_treapta_3_pat:1
- Mate:309: laterala_treapta_sus:1 ↔ front_sertar_scari:3
- Mate:310: front_suport_telefon_lateral:1 ↔ capac_noptiera:1
- Flush:249: front_picioare_cutie_suport_telefon:1 ↔ capac_noptiera:1
- Flush:250: front_suport_telefon_lateral:1 ↔ front_picioare_cutie_suport_telefon:1
## Named parameters: d221_d147 = 0 mm, d222_d148 = 0 mm, d223_d149 = 0 mm, d224_d150 = 0 mm, d225_d151 = 0 mm, d226_d152 = 0 mm, d227_d153 = 0 mm, d228_d154 = 0 mm, d229_d218 = 30 mm, d230_d219 = 30 mm, d231_d220 = 30 mm, d232_d213 = 0 mm, d233_d214 = 0 mm, d234_d215 = 0 mm, d235_d216 = 30 mm, d236_d217 = 30 mm
